# Autodesk Inventor assembly: mate-flexible2
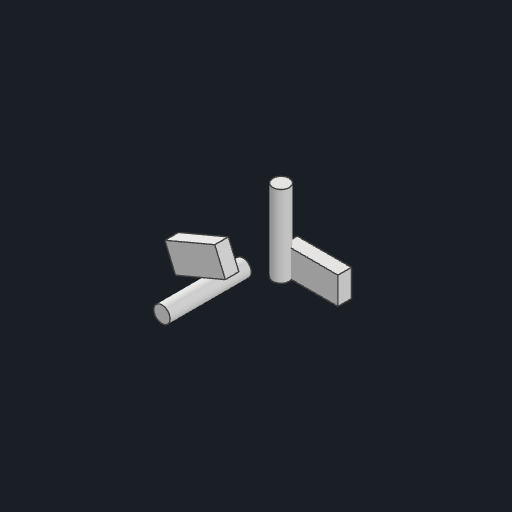
[picture p0: Inventor's stored thumbnail of the model, 512x512]
Saved by Autodesk Inventor 2026.1 (Build 301233000, 233)
## iProperties
Created: 2026-10-30
Part Number: mate-flexible2
Document SubType Name: Assembly
Designer: anony
Author: anony
## Documents named in this file (3)
- C:\Users\anony\OneDrive\Desktop\AI Projects\CAD Convert\corpus\generated\asm\mate-flexible2.iam
- C:\Users\anony\OneDrive\Desktop\AI Projects\CAD Convert\corpus\generated\asmparts\box.ipt
- C:\Users\anony\OneDrive\Desktop\AI Projects\CAD Convert\corpus\generated\asmsub\sub2.iam
## Components (2 placed, 2 different names)
1. box:1 — Mate:1
2. sub2:1 [sub-assembly] — Mate:1
## Relationships (1: Mate 1)
- Mate:1 (1 mm): box:1 ↔ sub2:1
